# Autodesk Inventor assembly: MM0948AN002_G50_001
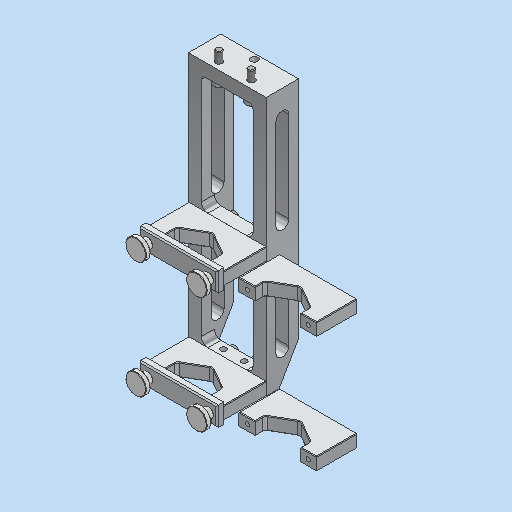
[picture p0: Inventor's stored thumbnail of the model, 512x512]
Saved by Autodesk Inventor 2023.3 (Build 273359000, 359)
## iProperties
Created: 2023-03-23
Part Number: MM0948AN002_G50_001
Description: =<RBPARTNOTITLE2>
Document SubType Name: Assembly
Designer: FH/Wi
Mass: 452.705 g
Surface Area: 697.213 cm^2
Volume: 153.29 cm^3
Density: 2.95326 g/cm^3
AnP_Kategorie: 99
AnP_Material: =<Material>
AnP_TemplVers: 20200821
RBDOCUMENTTYPE: DRF
RBDOCUMENTVERSION: 00
RBDRAWINGMAINSCALE: 1:1
RBDRAWINGMISSINGSPEC: --
RBDRAWINGVOLUME: --
RBDSV1: 0850
RBGBEDGESIN1: +0,5
RBGBEDGESIN2: +0,2
RBGBEDGESOUT1: -0,3
RBGBEDGESOUT2: -0,1
RBMATERIAL: =<Material>
RBMATMEETS: --
RBMATNO: =<Part Number>
RBPARTMADEOF: --
RBPARTNO: SIEHE MNR
RBPARTNOTITLE1: tube stabilizer
RBPARTNOTITLE2: Nadelhalter
RBPARTSAFETYINDICATOR: --
RBSURFACE: --
RBSURFACE2: --
RBZEDGESNORM: ISO13715:2002-06
RBZGENDIMCLASS: m
RBZGENDIMNORM: ISO 2768-1:1989-11
RBZGENGEOCLASS: H
RBZGENGEONORM: ISO 2768-2:1989-11
RBZSURFACENORM: ISO13D2:2002-02
RBZTOLERANCENORM: ISO 14405-1:2010-12
Author: FH/Wi
Keywords: =<RBPARTMADEOF>
Comments: =<RBSURFACE2>
Revision Number: 01
## Documents named in this file (9)
- C:\Users\rea9an\Documents\Inventor\TCAI2412_te1910_EM\AS00000931.iam
- C:\Users\rea9an\Documents\Inventor\TCAI2412_te1910_EM\PT00004576.ipt
- C:\Users\rea9an\Documents\Inventor\TCAI2412_te1910_EM\PT00004879.ipt
- C:\Users\rea9an\Documents\Inventor\TCAI2412_te1910_EM\PT00004577.ipt
- C:\Users\rea9an\Documents\Inventor\TCAI2412_te1910_EM\PT00004575.ipt
- C:\Users\rea9an\Documents\Inventor\TCAI2412_te1910_EM\PT00004869.ipt
- C:\Users\rea9an\Documents\Inventor\TCAI2412_te1910_EM\PT00004914.ipt
- C:\Users\rea9an\Documents\Inventor\TCAI2412_te1910_EM\PT00004585.ipt
- C:\Users\rea9an\Documents\Inventor\TCAI2412_te1910_EM\PT00004583.ipt
## Components (21 placed, 8 different names)
1. PT00004576:1 — Passend:6, Passend:8
2. PT00004879:1
3. PT00004879:2
4. PT00004577:1 — Fluchtend:1, Passend:7
5. PT00004575:1
6. PT00004585:2
7. PT00004585:3
8. PT00004577:2 — Fluchtend:2
9. PT00004575:2
10. PT00004585:5
11. PT00004585:4
12. PT00004869:1
13. PT00004869:2
14. PT00004869:3
15. PT00004869:4
16. PT00004914:1
17. PT00004914:2
18. PT00004914:3
19. PT00004914:4
20. PT00004583:1 — Passend:6, Fluchtend:1, Passend:7, Fluchtend:3
21. PT00004583:2 — Fluchtend:2, Passend:8, Fluchtend:3
## Relationships (29: Insert 18, Mate 8, Flush 3)
- [Mate]: PT00004577:1 ↔ PT00004575:1
- [Insert]: PT00004575:1 ↔ PT00004585:3
- [Insert]: PT00004575:1 ↔ PT00004585:2
- [Mate]: PT00004577:2 ↔ PT00004575:2
- [Insert]: PT00004575:2 ↔ PT00004585:4
- [Insert]: PT00004575:2 ↔ PT00004585:5
- [Mate]: PT00004576:1 ↔ PT00004577:2
- [Insert]: PT00004576:1 ↔ PT00004879:2
- [Insert]: PT00004576:1 ↔ PT00004879:1
- [Insert]: PT00004576:1 ↔ PT00004869:4
- [Insert]: PT00004576:1 ↔ PT00004869:3
- [Insert]: PT00004576:1 ↔ PT00004869:2
- [Insert]: PT00004576:1 ↔ PT00004869:1
- [Insert]: PT00004576:1 ↔ PT00004577:2
- [Mate]: PT00004576:1 ↔ PT00004577:2
- [Insert]: PT00004576:1 ↔ PT00004577:1
- [Mate]: PT00004576:1 ↔ PT00004577:1
- [Insert]: PT00004576:1 ↔ PT00004914:4
- [Insert]: PT00004576:1 ↔ PT00004914:3
- [Insert]: PT00004576:1 ↔ PT00004914:2
- [Insert]: PT00004576:1 ↔ PT00004914:1
- [Insert]: PT00004577:1 ↔ PT00004575:1
- [Insert]: PT00004577:2 ↔ PT00004575:2
- Passend:6 [Mate]: PT00004576:1 ↔ PT00004583:1
- Fluchtend:1 [Flush]: PT00004577:1 ↔ PT00004583:1
- Passend:7 [Mate] (10 mm): PT00004577:1 ↔ PT00004583:1
- Fluchtend:2 [Flush]: PT00004577:2 ↔ PT00004583:2
- Passend:8 [Mate]: PT00004576:1 ↔ PT00004583:2
- Fluchtend:3 [Flush]: PT00004583:1 ↔ PT00004583:2
## Named parameters: d308_d299 = 0 mm, d309_d300 = 0 mm, d311_d297 = 0 mm
